# Autodesk Inventor assembly: 로드셀 정적분석
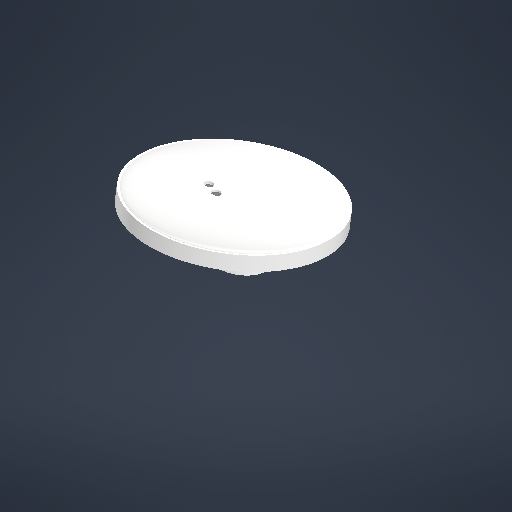
[picture p0: Inventor's stored thumbnail of the model, 512x512]
Saved by Autodesk Inventor 2026.2 (Build 302298010, 298A)
## iProperties
Created: 2026-03-24
Part Number: 로드셀 정적분석
Document SubType Name: Assembly
Designer: khw
Author: khw
## Documents named in this file (5)
- C:\Users\work\Desktop\ARD_v1\ARD_hardware\ARD_Model_v1\로드셀 정적분석.iam
- C:\Users\work\Desktop\ARD_v1\ARD_hardware\ARD_Model_v1\R-1.ipt
- C:\Users\work\Desktop\ARD_v1\ARD_hardware\ARD_Model_v1\R-2.ipt
- C:\Users\work\Desktop\ARD_v1\ARD_hardware\ARD_Model_v1\Object\로드셀 센서.ipt
- C:\Users\work\Desktop\ARD_v1\ARD_hardware\ARD_Model_v1\KS B 1003 - M 4 x 16.ipt
## Components (8 placed, 4 different names)
1. R-1:1 — 회전:3, 강체:1
2. R-2:1 — 회전:1, 회전:2
3. 로드셀 센서:1
4. KS B 1003 - M 4 x 16:1 — 회전:1
5. KS B 1003 - M 4 x 16:2 — 회전:2
6. KS B 1003 - M 4 x 16:3 — 회전:3
7. KS B 1003 - M 4 x 16:4 — 강체:1
8. KS B 1003 - M 4 x 16:5
## Relationships (10: Mate 6, RevoluteJoint 3, WeldJoint 1)
- [Mate]: R-2:1 ↔ 로드셀 센서:1
- [Mate]: R-2:1 ↔ 로드셀 센서:1
- [Mate]: R-1:1 ↔ 로드셀 센서:1
- [Mate]: R-1:1 ↔ 로드셀 센서:1
- [Mate]: R-1:1 ↔ 로드셀 센서:1
- [Mate]: R-2:1 ↔ 로드셀 센서:1
- 회전:1 [RevoluteJoint]: R-2:1 ↔ KS B 1003 - M 4 x 16:1
- 회전:2 [RevoluteJoint]: R-2:1 ↔ KS B 1003 - M 4 x 16:2
- 회전:3 [RevoluteJoint]: R-1:1 ↔ KS B 1003 - M 4 x 16:3
- 강체:1 [WeldJoint]: R-1:1 ↔ KS B 1003 - M 4 x 16:4
